# Autodesk Inventor assembly: mecanismo
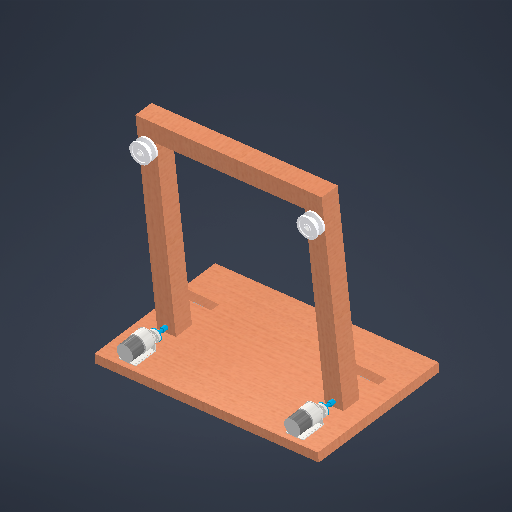
[picture p0: Inventor's stored thumbnail of the model, 512x512]
Saved by Autodesk Inventor 2026 (Build 300175000, 175)
## iProperties
Created: 2025-04-24
Part Number: mecanismo
Document SubType Name: Assembly
Designer: MARIA
Author: MARIA
## Documents named in this file (4)
- C:\Users\dawac\OneDrive\Área de Trabalho\poli2025.1\pi7\mecanismo\motor\mecanismo.iam
- C:\Users\dawac\OneDrive\Área de Trabalho\poli2025.1\pi7\mecanismo\suporte.ipt
- C:\Users\dawac\OneDrive\Área de Trabalho\poli2025.1\pi7\mecanismo\motor\motor_motando.iam
- C:\Users\dawac\OneDrive\Área de Trabalho\poli2025.1\pi7\mecanismo\polia\polia_montada.iam
## Components (5 placed, 3 different names)
1. suporte:1 — Mate:1, Mate:2, Mate:3, Mate:4, Cylindrical:1, Cylindrical:2
2. motor_motando:1 [sub-assembly] — Mate:3, Mate:4
3. motor_motando:2 [sub-assembly] — Mate:1, Mate:2
4. polia_montada:1 [sub-assembly] — Cylindrical:1
5. polia_montada:2 [sub-assembly] — Cylindrical:2
## Relationships (6: Mate 4, CylindricalJoint 2)
- Mate:1: suporte:1 ↔ motor_motando:2
- Mate:2: suporte:1 ↔ motor_motando:2
- Mate:3: suporte:1 ↔ motor_motando:1
- Mate:4: suporte:1 ↔ motor_motando:1
- Cylindrical:1: suporte:1 ↔ polia_montada:1
- Cylindrical:2: suporte:1 ↔ polia_montada:2
## Named parameters: Finish1_Area = 3489.55
note: some values were not read from the file. Shown as the stored number, unit unknown: "Finish1_Area".
